# Autodesk Inventor assembly: BG004_thutrn22_26_Biegeroboter_biegekopf_gesamt_allein
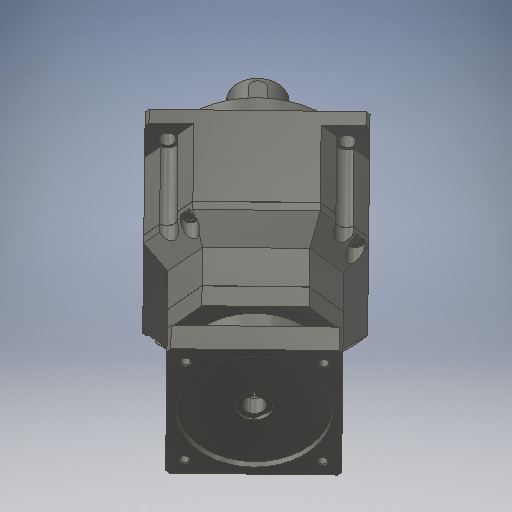
[picture p0: Inventor's stored thumbnail of the model, 512x512]
Saved by Autodesk Inventor 2025.3 (Build 293356000, 356)
## iProperties
Company: HTBLA Kaindorf
RuleStatus: InUse
Created: 2026-08-06
Part Number: BG004_thutrn22_26_Biegeroboter_biegekopf_gesamt_allein
Project: Biegeroboter
Material: Generisch
Description: biegekopf_gesamt_v1
Document SubType Name: Assembly
Designer: bensen22
Mass: 7718.21 g
Surface Area: 5961.75 cm^2
Volume: 3429.89 cm^3
Density: 2.25028 g/cm^3
AfterDocNew0: iProperties-Editor_aufrufen
Author: sebas
Keywords: 2026
## Documents named in this file (9)
- C:\Users\trist\Desktop\Schule\diplomarbeit_dateien\Mechanik\Biegekopf\Gehäuse\BG004_thutrn22_26_Biegeroboter_biegekopf_gesamt_allein.iam
- C:\Users\trist\Desktop\Schule\diplomarbeit_dateien\Mechanik\Biegekopf\MATSUSHITA_MSMF082L1U1\AIS2024\MSMF082L1U1.iam
- C:\Users\trist\Desktop\Schule\diplomarbeit_dateien\Mechanik\Biegekopf\188635080-9-gearbox_ab115-100-s2-p2-12\gearbox_ab115-100-s2-p2-12.ipt
- C:\Users\trist\Desktop\Schule\diplomarbeit_dateien\Mechanik\Biegekopf\Gehäuse\BT002_bensen22_26_Biegeroboter_gehäuse_motor_v1.ipt
- C:\Users\trist\Desktop\Schule\diplomarbeit_dateien\Mechanik\Biegekopf\Gehäuse\BT001_bensen22_26_Biegeroboter_gehäuse_getriebe_v1.ipt
- C:\Users\trist\Desktop\Schule\diplomarbeit_dateien\Mechanik\Biegekopf\Gehäuse\BT006_bensen22_26_Biegeroboter_gehäuse_motor_deckel_v2.ipt
- C:\Users\trist\Desktop\Schule\diplomarbeit_dateien\Mechanik\ATC_Kopfseite\AIS2024\SCHUNK-0302323 SWA-020-000-000, .iam
- C:\Users\trist\Documents\Inventor\Content Center Files\R2025\de-DE\AS 1427(03)\AS 1427 - M6 x 30(1).ipt
- C:\Users\trist\Desktop\Schule\diplomarbeit_dateien\Mechanik\Biegekopf\Gehäuse\BT017_thutrn22_26_Biegeroboter_gehäuse_oben.ipt
## Components (12 placed, 8 different names)
1. MSMF082L1U1:1 [sub-assembly] — Passend:1, Passend:2, Passend:3, Passend:4, Passend:8, Passend:16, Passend:18
2. gearbox_ab115-100-s2-p2-12:1 — Passend:1, Passend:2, Passend:10, Passend:11, Passend:12
3. BT002_bensen22_26_Biegeroboter_gehäuse_motor_v1:1 — Passend:3, Passend:4, Passend:8, Fluchtend:3, Passend:15, Fluchtend:4, Fluchtend:5
4. BT001_bensen22_26_Biegeroboter_gehäuse_getriebe_v1:1 — Passend:10, Passend:11, Passend:12, Fluchtend:3, Passend:26, Fluchtend:6, Fluchtend:7, Passend:27, Fluchtend:8, Fluchtend:9
5. BT006_bensen22_26_Biegeroboter_gehäuse_motor_deckel_v2:1 — Passend:15, Fluchtend:4, Fluchtend:5, Passend:19, Passend:20, Passend:22, Einfügen:1, Passend:25
6. SCHUNK-0302323 SWA-020-000-000, :1 [sub-assembly] — Passend:23, Passend:24, Passend:25
7. AS 1427 - Metrisch M6 x 30:1 — Passend:19, Passend:23
8. AS 1427 - Metrisch M6 x 30:2 — Passend:20
9. AS 1427 - Metrisch M6 x 30:4 — Einfügen:1
10. AS 1427 - Metrisch M6 x 30:5 — Passend:22, Passend:24
11. BT017_thutrn22_26_Biegeroboter_gehäuse_oben:1 — Passend:26, Fluchtend:6, Fluchtend:7
12. BT017_thutrn22_26_Biegeroboter_gehäuse_oben:2 — Passend:27, Fluchtend:8, Fluchtend:9
## Relationships (27: Mate 19, Flush 7, Insert 1)
- Passend:1 [Mate]: MSMF082L1U1:1 ↔ gearbox_ab115-100-s2-p2-12:1
- Passend:2 [Mate]: MSMF082L1U1:1 ↔ gearbox_ab115-100-s2-p2-12:1
- Passend:3 [Mate]: MSMF082L1U1:1 ↔ BT002_bensen22_26_Biegeroboter_gehäuse_motor_v1:1
- Passend:4 [Mate] (15 mm): MSMF082L1U1:1 ↔ BT002_bensen22_26_Biegeroboter_gehäuse_motor_v1:1
- Passend:8 [Mate] (15 mm): MSMF082L1U1:1 ↔ BT002_bensen22_26_Biegeroboter_gehäuse_motor_v1:1
- Passend:10 [Mate] (7.5 mm): gearbox_ab115-100-s2-p2-12:1 ↔ BT001_bensen22_26_Biegeroboter_gehäuse_getriebe_v1:1
- Passend:11 [Mate] (7.5 mm): gearbox_ab115-100-s2-p2-12:1 ↔ BT001_bensen22_26_Biegeroboter_gehäuse_getriebe_v1:1
- Passend:12 [Mate]: gearbox_ab115-100-s2-p2-12:1 ↔ BT001_bensen22_26_Biegeroboter_gehäuse_getriebe_v1:1
- Fluchtend:3 [Flush] (-10 mm): BT002_bensen22_26_Biegeroboter_gehäuse_motor_v1:1 ↔ BT001_bensen22_26_Biegeroboter_gehäuse_getriebe_v1:1
- Passend:15 [Mate]: BT002_bensen22_26_Biegeroboter_gehäuse_motor_v1:1 ↔ BT006_bensen22_26_Biegeroboter_gehäuse_motor_deckel_v2:1
- Fluchtend:4 [Flush]: BT002_bensen22_26_Biegeroboter_gehäuse_motor_v1:1 ↔ BT006_bensen22_26_Biegeroboter_gehäuse_motor_deckel_v2:1
- Fluchtend:5 [Flush]: BT002_bensen22_26_Biegeroboter_gehäuse_motor_v1:1 ↔ BT006_bensen22_26_Biegeroboter_gehäuse_motor_deckel_v2:1
- Passend:16 [Mate]: MSMF082L1U1:1
- Passend:18 [Mate]: MSMF082L1U1:1
- Passend:19 [Mate]: BT006_bensen22_26_Biegeroboter_gehäuse_motor_deckel_v2:1 ↔ AS 1427 - Metrisch M6 x 30:1
- Passend:20 [Mate]: BT006_bensen22_26_Biegeroboter_gehäuse_motor_deckel_v2:1 ↔ AS 1427 - Metrisch M6 x 30:2
- Passend:22 [Mate]: BT006_bensen22_26_Biegeroboter_gehäuse_motor_deckel_v2:1 ↔ AS 1427 - Metrisch M6 x 30:5
- Einfügen:1 [Insert]: BT006_bensen22_26_Biegeroboter_gehäuse_motor_deckel_v2:1 ↔ AS 1427 - Metrisch M6 x 30:4
- Passend:23 [Mate]: SCHUNK-0302323 SWA-020-000-000, :1 ↔ AS 1427 - Metrisch M6 x 30:1
- Passend:24 [Mate]: SCHUNK-0302323 SWA-020-000-000, :1 ↔ AS 1427 - Metrisch M6 x 30:5
- Passend:25 [Mate]: BT006_bensen22_26_Biegeroboter_gehäuse_motor_deckel_v2:1 ↔ SCHUNK-0302323 SWA-020-000-000, :1
- Passend:26 [Mate]: BT001_bensen22_26_Biegeroboter_gehäuse_getriebe_v1:1 ↔ BT017_thutrn22_26_Biegeroboter_gehäuse_oben:1
- Fluchtend:6 [Flush]: BT001_bensen22_26_Biegeroboter_gehäuse_getriebe_v1:1 ↔ BT017_thutrn22_26_Biegeroboter_gehäuse_oben:1
- Fluchtend:7 [Flush]: BT001_bensen22_26_Biegeroboter_gehäuse_getriebe_v1:1 ↔ BT017_thutrn22_26_Biegeroboter_gehäuse_oben:1
- Passend:27 [Mate]: BT001_bensen22_26_Biegeroboter_gehäuse_getriebe_v1:1 ↔ BT017_thutrn22_26_Biegeroboter_gehäuse_oben:2
- Fluchtend:8 [Flush]: BT001_bensen22_26_Biegeroboter_gehäuse_getriebe_v1:1 ↔ BT017_thutrn22_26_Biegeroboter_gehäuse_oben:2
- Fluchtend:9 [Flush]: BT001_bensen22_26_Biegeroboter_gehäuse_getriebe_v1:1 ↔ BT017_thutrn22_26_Biegeroboter_gehäuse_oben:2
